# Autodesk Inventor assembly: BG007_thutrn22_26
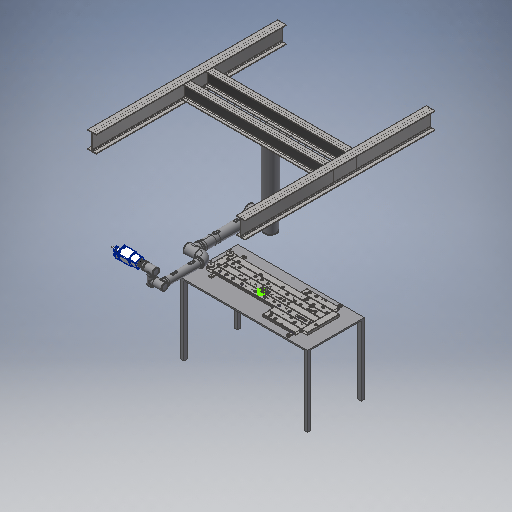
[picture p0: Inventor's stored thumbnail of the model, 512x512]
Saved by Autodesk Inventor 2025.3 (Build 293356000, 356)
## iProperties
Company: HTBLA Kaindorf
RuleStatus: InUse
Created: 2026-08-13
Part Number: BG007_thutrn22_26
Project: Biegeroboter
Material: Generisch
Description: gesamt_v2
Document SubType Name: Assembly
Designer: thutrn22
Mass: 507833 g
Surface Area: 242742 cm^2
Volume: 153951 cm^3
Density: 3.29868 g/cm^3
AfterDocNew0: iProperties-Editor_aufrufen
Author: trist
Keywords: 2026
## Documents named in this file (10)
- C:\Users\trist\Desktop\Schule\diplomarbeit_dateien\Mechanik\Biegekopf\Gesamte Baugruppen\BG007_thutrn22_26_Biegeroboter_gesamt_v2.iam
- C:\Users\trist\Desktop\Schule\diplomarbeit_dateien\Mechanik\Biegekopf\Gehäuse\BG004_thutrn22_26_Biegeroboter_biegekopf_gesamt_allein.iam
- C:\Users\trist\Desktop\Schule\diplomarbeit_dateien\Mechanik\Fairino FR20\Fairino FR20.iam
- C:\Users\trist\Desktop\Schule\diplomarbeit_dateien\Mechanik\Biegekopf\Verlängerung\BG003_thutrn22_26_Biegeroboter_verlängerung_gesamt_v2.iam
- C:\Users\trist\Desktop\Schule\diplomarbeit_dateien\Mechanik\Adapter\SCHUNK-0302201 A-SWK-020-ISO-A50.ipt
- C:\Users\trist\Desktop\Schule\diplomarbeit_dateien\Mechanik\ATC\AIS2024\SCHUNK-0302322 SWK-020-000-000, .iam
- C:\Users\trist\Desktop\Schule\diplomarbeit_dateien\Mechanik\Biegekopf\Deckenkonstruktion\BG004_bensen22_26_Biegeroboter_deckenkonstruktion_gesamt_v1.iam
- C:\Users\trist\Desktop\Schule\diplomarbeit_dateien\Mechanik\Biegekopf\Gesamte Baugruppen\BT015_thutrn22_26_Biegeroboter_Tisch.ipt
- C:\Users\trist\Desktop\Schule\diplomarbeit_dateien\Mechanik\Gesamtprojekt Biegelehre\Biegelehre\Biegelehre\Biegelehre.iam
- C:\Users\trist\Desktop\Schule\diplomarbeit_dateien\Mechanik\Fairino FR20\Cobot_Stand\Cobot_Stand\Cobot_Stand.ipt
## Components (9 placed, 9 different names)
1. BG004_thutrn22_26_Biegeroboter_biegekopf_gesamt_allein:1 [sub-assembly] — Passend:7, Passend:8, Passend:9, Passend:10
2. BG003_thutrn22_26_Biegeroboter_verlängerung_gesamt_v2:1 [sub-assembly] — Passend:9, Passend:10
3. Fairino FR20:1 [sub-assembly] — Passend:1, Passend:2, Passend:3, Passend:4, Passend:19, Passend:20
4. SCHUNK-0302201 A-SWK-020-ISO-A50:1 — Passend:1, Passend:2, Passend:3, Passend:4, Passend:5, Passend:6
5. SCHUNK-0302322 SWK-020-000-000, :1 [sub-assembly] — Passend:5, Passend:6, Passend:7, Passend:8
6. BG004_bensen22_26_Biegeroboter_deckenkonstruktion_gesamt_v1:1 [sub-assembly] — Fluchtend:3, Fluchtend:5, Fluchtend:6, Passend:18, Fluchtend:7, Fluchtend:8
7. BT015_thutrn22_26_Biegeroboter_Tisch:1 — Passend:17, Fluchtend:1, Fluchtend:2, Fluchtend:3, Fluchtend:5, Fluchtend:6
8. Biegelehre:1 [sub-assembly] — Passend:17, Fluchtend:1, Fluchtend:2
9. Cobot_Stand:1 — Passend:18, Fluchtend:7, Fluchtend:8, Passend:19, Passend:20
## Relationships (21: Mate 14, Flush 7)
- Passend:1 [Mate]: Fairino FR20:1 ↔ SCHUNK-0302201 A-SWK-020-ISO-A50:1
- Passend:2 [Mate]: Fairino FR20:1 ↔ SCHUNK-0302201 A-SWK-020-ISO-A50:1
- Passend:3 [Mate]: Fairino FR20:1 ↔ SCHUNK-0302201 A-SWK-020-ISO-A50:1
- Passend:4 [Mate]: Fairino FR20:1 ↔ SCHUNK-0302201 A-SWK-020-ISO-A50:1
- Passend:5 [Mate]: SCHUNK-0302201 A-SWK-020-ISO-A50:1 ↔ SCHUNK-0302322 SWK-020-000-000, :1
- Passend:6 [Mate]: SCHUNK-0302201 A-SWK-020-ISO-A50:1 ↔ SCHUNK-0302322 SWK-020-000-000, :1
- Passend:7 [Mate]: BG004_thutrn22_26_Biegeroboter_biegekopf_gesamt_allein:1 ↔ SCHUNK-0302322 SWK-020-000-000, :1
- Passend:8 [Mate]: BG004_thutrn22_26_Biegeroboter_biegekopf_gesamt_allein:1 ↔ SCHUNK-0302322 SWK-020-000-000, :1
- Passend:9 [Mate]: BG004_thutrn22_26_Biegeroboter_biegekopf_gesamt_allein:1 ↔ BG003_thutrn22_26_Biegeroboter_verlängerung_gesamt_v2:1
- Passend:10 [Mate]: BG004_thutrn22_26_Biegeroboter_biegekopf_gesamt_allein:1 ↔ BG003_thutrn22_26_Biegeroboter_verlängerung_gesamt_v2:1
- Passend:17 [Mate]: BT015_thutrn22_26_Biegeroboter_Tisch:1 ↔ Biegelehre:1
- Fluchtend:1 [Flush] (200 mm): BT015_thutrn22_26_Biegeroboter_Tisch:1 ↔ Biegelehre:1
- Fluchtend:2 [Flush] (105 mm): BT015_thutrn22_26_Biegeroboter_Tisch:1 ↔ Biegelehre:1
- Fluchtend:3 [Flush] (-250 mm): BG004_bensen22_26_Biegeroboter_deckenkonstruktion_gesamt_v1:1 ↔ BT015_thutrn22_26_Biegeroboter_Tisch:1
- Fluchtend:5 [Flush] (242.5 mm): BG004_bensen22_26_Biegeroboter_deckenkonstruktion_gesamt_v1:1 ↔ BT015_thutrn22_26_Biegeroboter_Tisch:1
- Fluchtend:6 [Flush] (3375 mm): BG004_bensen22_26_Biegeroboter_deckenkonstruktion_gesamt_v1:1 ↔ BT015_thutrn22_26_Biegeroboter_Tisch:1
- Passend:18 [Mate]: BG004_bensen22_26_Biegeroboter_deckenkonstruktion_gesamt_v1:1 ↔ Cobot_Stand:1
- Fluchtend:7 [Flush] (42.95 mm): BG004_bensen22_26_Biegeroboter_deckenkonstruktion_gesamt_v1:1 ↔ Cobot_Stand:1
- Fluchtend:8 [Flush] (1052.5 mm): BG004_bensen22_26_Biegeroboter_deckenkonstruktion_gesamt_v1:1 ↔ Cobot_Stand:1
- Passend:19 [Mate]: Fairino FR20:1 ↔ Cobot_Stand:1
- Passend:20 [Mate]: Fairino FR20:1 ↔ Cobot_Stand:1
